# Autodesk Inventor assembly: Assembly1
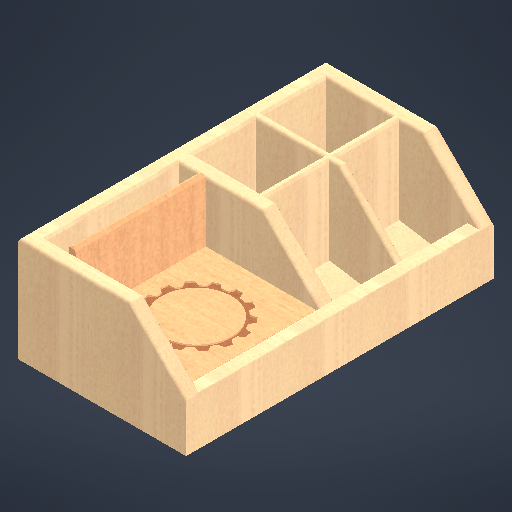
[picture p0: Inventor's stored thumbnail of the model, 512x512]
Saved by Autodesk Inventor 2027.1 (Build 311270010, 270A)
## iProperties
Created: 2026-10-22
Part Number: Assembly1
Document SubType Name: Assembly
Designer: wh29971
Author: wh29971
## Documents named in this file (3)
- C:\Users\willh\OneDrive\Documents\Autodesk\parts\caddy assembly.iam
- C:\Users\willh\OneDrive\Documents\Autodesk\parts\revisedcaddy.ipt
- C:\Users\willh\OneDrive\Documents\Autodesk\parts\caddy top.ipt
## Components (2 placed, 2 different names)
1. revisedcaddy:1 — Mate:1, Flush:2, Mate:2
2. caddy top:1 — Mate:1, Flush:2, Mate:2
## Relationships (3: Mate 2, Flush 1)
- Mate:1: revisedcaddy:1 ↔ caddy top:1
- Flush:2 (-94 mm): revisedcaddy:1 ↔ caddy top:1
- Mate:2 (1 mm): revisedcaddy:1 ↔ caddy top:1
